# Autodesk Inventor assembly: sliding-assembly-monotaro
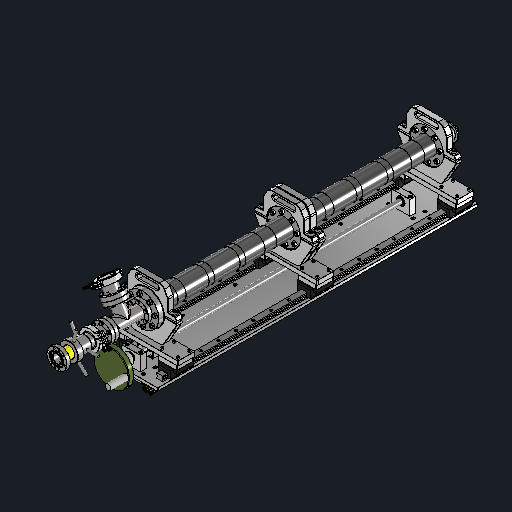
[picture p0: Inventor's stored thumbnail of the model, 512x512]
Saved by Autodesk Inventor 2027.1 (Build 311270010, 270A)
## iProperties
Created: 2026-11-14
Part Number: sliding-assembly-monotaro
Document SubType Name: Assembly
Designer: queezz
Author: queezz
## Documents named in this file (15)
- C:\Users\queezz\Dropbox\Drawings\pihti-cad\bellows-probe\sliding-assembly-monotaro.iam
- C:\Users\queezz\Dropbox\Drawings\pihti-cad\bellows-probe\instead-of-bellows-100mm.ipt
- C:\Users\queezz\Dropbox\Drawings\pihti-cad\bellows-probe\monotaro-bed-module.iam
- C:\Users\queezz\Dropbox\Drawings\pihti-cad\bellows-probe\monotaro-front-module.iam
- C:\Users\queezz\Dropbox\Drawings\pihti-cad\bellows-probe\monotaro-middle-module.iam
- C:\Users\queezz\Dropbox\Drawings\pihti-cad\bellows-probe\monotaro-rear-module.iam
- C:\Users\queezz\Dropbox\Drawings\pihti-cad\bellows-probe\monotaro-telescope-sleeve-3.ipt
- C:\Users\queezz\Dropbox\Drawings\pihti-cad\bellows-probe\monotaro-telescope-sleeve-4.ipt
- C:\Users\queezz\Dropbox\Drawings\pihti-cad\bellows-probe\monotaro-telescope-sleeve-7.ipt
- C:\Users\queezz\Dropbox\Drawings\pihti-cad\bellows-probe\monotaro-telescope-sleeve-8.ipt
- C:\Users\queezz\Dropbox\Drawings\pihti-cad\bellows-probe\monotaro-telescope-sleeve-extra1.ipt
- C:\Users\queezz\Dropbox\Drawings\pihti-cad\bellows-probe\monotaro-telescope-sleeve-extra2.ipt
- C:\Users\queezz\Dropbox\Drawings\pihti-cad\bellows-probe\monotaro-telescope-sleeve-2.ipt
- C:\Users\queezz\Dropbox\Drawings\pihti-cad\bellows-probe\monotaro-telescope-sleeve-6.ipt
- C:\Users\queezz\Dropbox\Drawings\pihti-cad\bellows-probe\monotaro-telescope-sleeve-5.ipt
## Components (14 placed, 7 different names)
1. instead-of-bellows:1 — Flush:12, Mate:4, Flush:13, Mate:6
2. instead-of-bellows:2 — Flush:7, Flush:8, Mate:5, Flush:14
3. instead-of-bellows:3 — Flush:9, Mate:1, Flush:14, Flush:15
4. instead-of-bellows:4 — Flush:11, Mate:3, Flush:16, Mate:6
5. instead-of-bellows:5 — Flush:22, Mate:10, Flush:23, Mate:12
6. instead-of-bellows:6 — Flush:17, Flush:18, Mate:11, Flush:24
7. instead-of-bellows:7 — Mate:7, Flush:19, Flush:24, Flush:25
8. instead-of-bellows:8 — Flush:21, Mate:9, Flush:26, Mate:12
9. Bellows 1 extra telescope section — Flush:10, Mate:2, Flush:15, Flush:16
10. Bellows 2 extra telescope section — Flush:20, Mate:8, Flush:25, Flush:26
11. Bed module [sub-assembly] — Drive nut captured by rear saddle
12. Front module [sub-assembly] — Vessel bellows 135 to 485 mm, Flush:13, Vessel drawing position
13. Middle module [sub-assembly] — Flush:1, Flush:2, Vessel bellows 135 to 485 mm, Rear bellows 135 to 485 mm, Mate:5, Flush:23, Vessel drawing position, Rear drawing position
14. Rear module [sub-assembly] — Flush:3, Flush:4, Rear bellows 135 to 485 mm, Mate:11, Drive nut captured by rear saddle, Rear drawing position
## Relationships (41: Flush 29, Mate 12)
- Flush:1: Middle module
- Flush:2: Middle module
- Flush:3: Rear module
- Flush:4: Rear module
- Vessel bellows 135 to 485 mm [Flush] (476 mm): Front module ↔ Middle module
- Rear bellows 135 to 485 mm [Flush] (476 mm): Middle module ↔ Rear module
- Flush:7: instead-of-bellows:2
- Flush:8 (105 mm): instead-of-bellows:2
- Flush:9: instead-of-bellows:3
- Mate:1 (105 mm): instead-of-bellows:3
- Flush:10: Bellows 1 extra telescope section
- Mate:2 (105 mm): Bellows 1 extra telescope section
- Flush:11: instead-of-bellows:4
- Mate:3 (105 mm): instead-of-bellows:4
- Flush:12: instead-of-bellows:1
- Mate:4 (105 mm): instead-of-bellows:1
- Mate:5 (119.504 mm): instead-of-bellows:2 ↔ Middle module
- Flush:13 (-91.168 mm): instead-of-bellows:1 ↔ Front module
- Flush:14 (-100 mm): instead-of-bellows:2 ↔ instead-of-bellows:3
- Flush:15 (-100 mm): instead-of-bellows:3 ↔ Bellows 1 extra telescope section
- Flush:16 (-92.157 mm): instead-of-bellows:4 ↔ Bellows 1 extra telescope section
- Mate:6 (9.493 mm): instead-of-bellows:1 ↔ instead-of-bellows:4
- Flush:17: instead-of-bellows:6
- Flush:18 (105 mm): instead-of-bellows:6
- Mate:7: instead-of-bellows:7
- Flush:19 (105 mm): instead-of-bellows:7
- Flush:20: Bellows 2 extra telescope section
- Mate:8 (105 mm): Bellows 2 extra telescope section
- Flush:21: instead-of-bellows:8
- Mate:9 (105 mm): instead-of-bellows:8
- Flush:22: instead-of-bellows:5
- Mate:10 (105 mm): instead-of-bellows:5
- Mate:11 (91.168 mm): instead-of-bellows:6 ↔ Rear module
- Flush:23 (-115.775 mm): instead-of-bellows:5 ↔ Middle module
- Flush:24 (-92.157 mm): instead-of-bellows:6 ↔ instead-of-bellows:7
- Flush:25 (-100 mm): instead-of-bellows:7 ↔ Bellows 2 extra telescope section
- Flush:26 (-95.2075 mm): instead-of-bellows:8 ↔ Bellows 2 extra telescope section
- Mate:12 (4.7005 mm): instead-of-bellows:5 ↔ instead-of-bellows:8
- Drive nut captured by rear saddle [Flush] (-12.5 mm): Bed module ↔ Rear module
- Vessel drawing position [Flush] (476 mm): Front module ↔ Middle module
- Rear drawing position [Flush] (476 mm): Middle module ↔ Rear module
